# Autodesk Inventor assembly: ensamble_corteacrilico
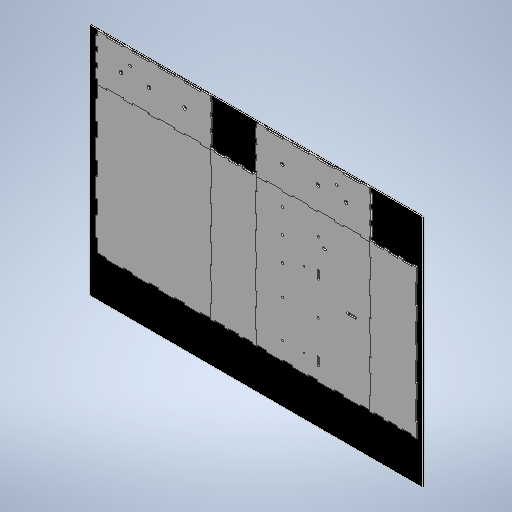
[picture p0: Inventor's stored thumbnail of the model, 512x512]
Saved by Autodesk Inventor 2025.2 (Build 292293000, 293)
## iProperties
Created: 2025-05-21
Part Number: ensamble_corteacrilico
Document SubType Name: Assembly
Designer: laura
Author: laura
## Documents named in this file (6)
- C:\Users\laura\OneDrive - Universidad de los andes\Documentos\7mo semestre\Dinámica de Maquinaria\Taller 3\ensamble_corteacrilico.iam
- C:\Users\laura\OneDrive - Universidad de los andes\Documentos\7mo semestre\Dinámica de Maquinaria\Taller 3\archivos_imprimir\acrilico.ipt
- C:\Users\laura\OneDrive - Universidad de los andes\Documentos\7mo semestre\Dinámica de Maquinaria\Taller 3\Tapa_orquesta.ipt
- C:\Users\laura\OneDrive - Universidad de los andes\Documentos\7mo semestre\Dinámica de Maquinaria\Taller 3\Lateral_derecho.ipt
- C:\Users\laura\OneDrive - Universidad de los andes\Documentos\7mo semestre\Dinámica de Maquinaria\Taller 3\pared1.ipt
- C:\Users\laura\OneDrive - Universidad de los andes\Documentos\7mo semestre\Dinámica de Maquinaria\Taller 3\piso.ipt
## Components (7 placed, 5 different names)
1. acrilico:1 — Mate:1, Mate:2, Mate:3, Mate:4, Mate:10, Mate:13, Flush:4, Flush:5
2. Tapa_orquesta:1 — Mate:1, Mate:7, Mate:8, Flush:2, Mate:9, Mate:11
3. Lateral_derecho:1 — Mate:2, Mate:15, Flush:6
4. Lateral_derecho:2 — Mate:3, Mate:8, Flush:2, Mate:12, Flush:5
5. pared1:1 — Mate:10, Mate:11, Mate:12, Mate:14, Flush:3
6. pared1:2 — Mate:4, Mate:7, Mate:9, Flush:4
7. piso:1 — Mate:13, Mate:14, Flush:3, Mate:15, Flush:6
## Relationships (18: Mate 13, Flush 5)
- Mate:1: acrilico:1 ↔ Tapa_orquesta:1
- Mate:2: acrilico:1 ↔ Lateral_derecho:1
- Mate:3: acrilico:1 ↔ Lateral_derecho:2
- Mate:4: acrilico:1 ↔ pared1:2
- Mate:7: Tapa_orquesta:1 ↔ pared1:2
- Mate:8: Tapa_orquesta:1 ↔ Lateral_derecho:2
- Flush:2: Tapa_orquesta:1 ↔ Lateral_derecho:2
- Mate:9 (-3 mm): Tapa_orquesta:1 ↔ pared1:2
- Mate:10: acrilico:1 ↔ pared1:1
- Mate:11: Tapa_orquesta:1 ↔ pared1:1
- Mate:12 (-3 mm): Lateral_derecho:2 ↔ pared1:1
- Mate:13: acrilico:1 ↔ piso:1
- Mate:14: pared1:1 ↔ piso:1
- Flush:3: pared1:1 ↔ piso:1
- Flush:4 (10 mm): acrilico:1 ↔ pared1:2
- Flush:5: acrilico:1 ↔ Lateral_derecho:2
- Mate:15: Lateral_derecho:1 ↔ piso:1
- Flush:6: Lateral_derecho:1 ↔ piso:1
